# Autodesk Inventor assembly: COTS_AMPHENOL_901-2PF705590AM_SMA_Connector_SIM
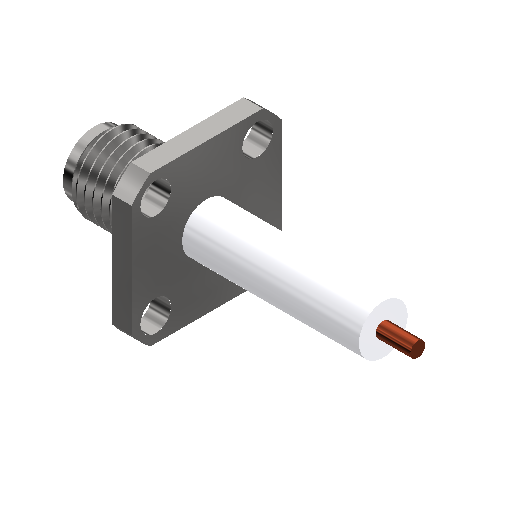
[picture p0: Inventor's stored thumbnail of the model, 512x512]
Saved by Autodesk Inventor 2026.1 (Build 301233000, 233)
## iProperties
Created: 2025-11-05
Part Number: COTS_AMPHENOL_901-2PF705590AM_SMA_Connector_SIM
Document SubType Name: Assembly
Designer: User
Author: User
## Documents named in this file (4)
- C:\Users\Andrzej\OneDrive\_DRIVE_SYNCH_FILES\RFC - #4 PCB Coaxial Feed Horn Antenna (3-7 GHz)\MCAD\2_FR4_PANELS_TAB_AND_SLOT\__COTS_PARTS\COTS_AMPHENOL_901-2PF705590AM_SMA_Connector\COTS_AMPHENOL_901-2PF705590AM_SMA_Connector_SIM.iam
- C:\Users\Andrzej\OneDrive\_DRIVE_SYNCH_FILES\RFC - #4 PCB Coaxial Feed Horn Antenna (3-7 GHz)\MCAD\2_FR4_PANELS_TAB_AND_SLOT\__COTS_PARTS\COTS_AMPHENOL_901-2PF705590AM_SMA_Connector\COTS_AMPHENOL_901-2PF705590AM_SMA_Connector_Center_Conductor.ipt
- C:\Users\Andrzej\OneDrive\_DRIVE_SYNCH_FILES\RFC - #4 PCB Coaxial Feed Horn Antenna (3-7 GHz)\MCAD\2_FR4_PANELS_TAB_AND_SLOT\__COTS_PARTS\COTS_AMPHENOL_901-2PF705590AM_SMA_Connector\COTS_AMPHENOL_901-2PF705590AM_SMA_Connector_Dielectric.ipt
- C:\Users\Andrzej\OneDrive\_DRIVE_SYNCH_FILES\RFC - #4 PCB Coaxial Feed Horn Antenna (3-7 GHz)\MCAD\2_FR4_PANELS_TAB_AND_SLOT\__COTS_PARTS\COTS_AMPHENOL_901-2PF705590AM_SMA_Connector\COTS_AMPHENOL_901-2PF705590AM_SMA_Connector_Body.ipt
## Components (3 placed, 3 different names)
1. COTS_AMPHENOL_901-2PF705590AM_SMA_Connector_Center_Conductor:1 — Mate:2, Flush:2
2. COTS_AMPHENOL_901-2PF705590AM_SMA_Connector_Dielectric:1 — Mate:1, Flush:1, Mate:2, Flush:2
3. COTS_AMPHENOL_901-2PF705590AM_SMA_Connector_Body:1 — Mate:1, Flush:1
## Relationships (4: Mate 2, Flush 2)
- Mate:1: COTS_AMPHENOL_901-2PF705590AM_SMA_Connector_Dielectric:1 ↔ COTS_AMPHENOL_901-2PF705590AM_SMA_Connector_Body:1
- Flush:1: COTS_AMPHENOL_901-2PF705590AM_SMA_Connector_Dielectric:1 ↔ COTS_AMPHENOL_901-2PF705590AM_SMA_Connector_Body:1
- Mate:2: COTS_AMPHENOL_901-2PF705590AM_SMA_Connector_Center_Conductor:1 ↔ COTS_AMPHENOL_901-2PF705590AM_SMA_Connector_Dielectric:1
- Flush:2: COTS_AMPHENOL_901-2PF705590AM_SMA_Connector_Center_Conductor:1 ↔ COTS_AMPHENOL_901-2PF705590AM_SMA_Connector_Dielectric:1
